# Autodesk Inventor assembly: SE0004AN001_G01_816
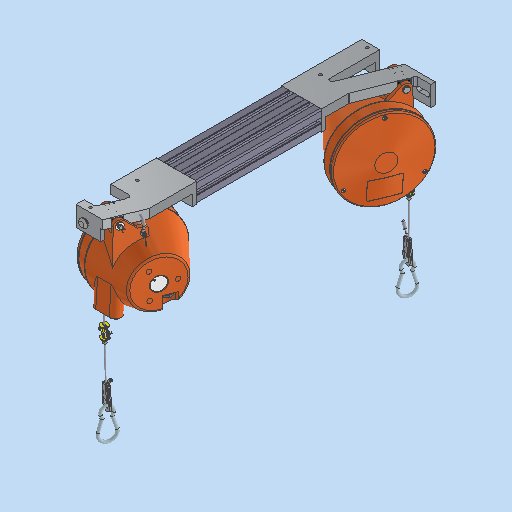
[picture p0: Inventor's stored thumbnail of the model, 512x512]
Saved by Autodesk Inventor 2023.3 (Build 273359000, 359)
## iProperties
RuleStatus: InUse
Created: 2021-12-07
Part Number: SE0004AN001_G01_816
Description: =<RBPARTNOTITLE2>
Document SubType Name: Assembly
Designer: frt9bw
Mass: 7843.71 g
Surface Area: 6717.74 cm^2
Volume: 6011.32 cm^3
Density: 1.30482 g/cm^3
AnP_Material: =<Material>
AnP_TemplVers: 20200821
RBDOCUMENTTYPE: DRF
RBDOCUMENTVERSION: 00
RBDRAWINGMAINSCALE: 1:1
RBDRAWINGMISSINGSPEC: --
RBDRAWINGVOLUME: --
RBDSV1: 0850
RBGBEDGESIN1: +0,5
RBGBEDGESIN2: +0,2
RBGBEDGESOUT1: -0,3
RBGBEDGESOUT2: -0,1
RBMATERIAL: =<Material>
RBMATMEETS: --
RBMATNO: =<Part Number>
RBPARTMADEOF: --
RBPARTNO: SIEHE MNR
RBPARTNOTITLE1: --
RBPARTSAFETYINDICATOR: --
RBSURFACE: --
RBSURFACE2: --
RBZEDGESNORM: ISO13715:2002-06
RBZGENDIMCLASS: m
RBZGENDIMNORM: ISO 2768-1:1989-11
RBZGENGEOCLASS: H
RBZGENGEONORM: ISO 2768-2:1989-11
RBZSURFACENORM: ISO13D2:2002-02
RBZTOLERANCENORM: ISO 14405-1:2010-12
Author: frt9bw
Keywords: =<RBPARTMADEOF>
Comments: =<RBSURFACE2>
Revision Number: 01
## Documents named in this file (7)
- C:\Users\rea9an\Documents\Inventor\TCAI2412_te1910_EM\AS00000985.iam
- C:\Users\rea9an\Documents\Inventor\TCAI2412_te1910_EM\PT00004808.ipt
- C:\Users\rea9an\Documents\Inventor\TCAI2412_te1910_EM\PT00004809.ipt
- C:\Users\rea9an\Documents\Inventor\TCAI2412_te1910_EM\PT00004811.ipt
- C:\Users\rea9an\Documents\Inventor\TCAI2412_te1910_EM\PT00004307.ipt
- C:\Users\rea9an\Documents\Inventor\TCAI2412_te1910_EM\PT00004305.ipt
- C:\Users\rea9an\Documents\Inventor\TCAI2412_te1910_EM\PT00004325.ipt
## Components (11 placed, 6 different names)
1. PT00004808:2 — Fluchtend:1, Fluchtend:2, Einfügen:1, Passend:1, Einfügen:3, Einfügen:4, Einfügen:8
2. PT00004809:1 — Fluchtend:1, Fluchtend:2, Einfügen:2, Passend:1, Einfügen:5, Einfügen:6, Einfügen:7
3. PT00004811:1 — Einfügen:2
4. PT00004811:2 — Einfügen:1
5. PT00004325:1
6. PT00004307:1 — Einfügen:6
7. PT00004307:2 — Einfügen:5
8. PT00004307:3 — Einfügen:3
9. PT00004307:4 — Einfügen:4
10. PT00004305:1 — Einfügen:8
11. PT00004305:2 — Einfügen:7
## Relationships (14: Insert 8, Flush 4, Mate 2)
- Fluchtend:1 [Flush]: PT00004808:2 ↔ PT00004809:1
- Fluchtend:2 [Flush]: PT00004808:2 ↔ PT00004809:1
- Einfügen:1 [Insert]: PT00004808:2 ↔ PT00004811:2
- Einfügen:2 [Insert]: PT00004809:1 ↔ PT00004811:1
- Passend:1 [Mate] (-640 mm): PT00004808:2 ↔ PT00004809:1
- [Flush]: PT00004809:1 ↔ PT00004325:1
- [Mate] (-22.5 mm): PT00004809:1 ↔ PT00004325:1
- [Flush] (45 mm): PT00004809:1 ↔ PT00004325:1
- Einfügen:3 [Insert]: PT00004808:2 ↔ PT00004307:3
- Einfügen:4 [Insert]: PT00004808:2 ↔ PT00004307:4
- Einfügen:5 [Insert]: PT00004809:1 ↔ PT00004307:2
- Einfügen:6 [Insert]: PT00004809:1 ↔ PT00004307:1
- Einfügen:7 [Insert] (5 mm): PT00004809:1 ↔ PT00004305:2
- Einfügen:8 [Insert] (5 mm): PT00004808:2 ↔ PT00004305:1
